# Autodesk Inventor assembly: Cantoneira dupla perfil
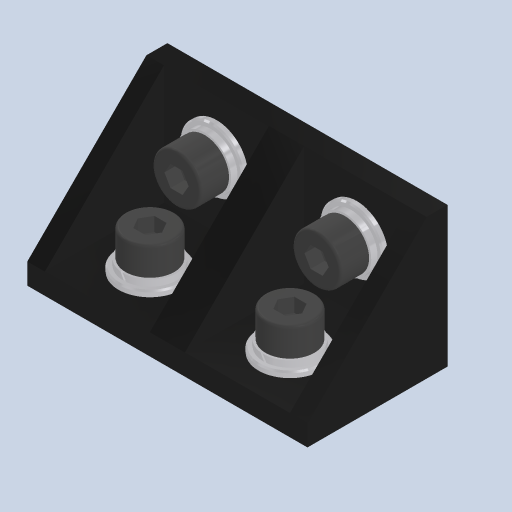
[picture p0: Inventor's stored thumbnail of the model, 512x512]
Saved by Autodesk Inventor 2024.3 (Build 283343000, 343)
## iProperties
Created: 2025-02-22
Part Number: Cantoneira dupla perfil
Document SubType Name: Assembly
Designer: Cliente
Author: Cliente
## Documents named in this file (6)
- C:\Users\Cliente\Desktop\TCC\Base\Fixação\Cantoneira dupla perfil.iam
- C:\Users\Cliente\Desktop\TCC\Base\Impresso\Cantoneira dupla perfil.ipt
- C:\Users\Cliente\Desktop\TCC\Base\Fixação\Arruela lisa DIN 125 B M4.ipt
- C:\Users\Cliente\Desktop\TCC\Base\Fixação\Arruela de pressão DIN 127 B M4.ipt
- C:\Users\Cliente\Desktop\TCC\Base\Fixação\Parafuso allen cabeça cilíndrica DIN 912 M4x10.ipt
- C:\Users\Cliente\Desktop\TCC\Base\Fixação\Porca martelo M4 canal 6.ipt
## Components (17 placed, 5 different names)
1. Cantoneira dupla perfil:1 — Alinhado:1, Alinhado:2, Alinhado:3, Coincidente:1, Coincidente:2, Coincidente:3, Coincidente:4, Coincidente:5, Coincidente:6, Coincidente:7, Coincidente:8, Ângulo:9, Ângulo:10, Ângulo:11, Ângulo:12, Coincidente:26, Ângulo:13, Ângulo:14, Coincidente:28, Coincidente:30, Ângulo:15, Ângulo:16, Coincidente:32
2. Arruela lisa DIN 125 B M4:1 — Coincidente:1, Coincidente:5, Ângulo:1, Coincidente:9, Coincidente:13
3. Arruela lisa DIN 125 B M4:2 — Coincidente:2, Coincidente:6, Ângulo:2, Coincidente:10, Coincidente:14
4. Arruela lisa DIN 125 B M4:3 — Coincidente:3, Coincidente:7, Ângulo:3, Coincidente:11, Coincidente:15
5. Arruela lisa DIN 125 B M4:4 — Coincidente:4, Coincidente:8, Ângulo:4, Coincidente:12, Coincidente:16
6. Arruela de pressão DIN 127 B M4:1 — Coincidente:9, Coincidente:13, Ângulo:5, Coincidente:17, Coincidente:21
7. Arruela de pressão DIN 127 B M4:2 — Coincidente:10, Coincidente:14, Ângulo:6, Coincidente:18, Coincidente:22
8. Arruela de pressão DIN 127 B M4:3 — Coincidente:11, Coincidente:15, Ângulo:7, Coincidente:19, Coincidente:23
9. Arruela de pressão DIN 127 B M4:4 — Coincidente:12, Coincidente:16, Ângulo:8, Coincidente:20, Coincidente:24
10. Parafuso allen cabeça cilíndrica DIN 912 M4x10:1 — Coincidente:17, Coincidente:21, Ângulo:9, Coincidente:25
11. Parafuso allen cabeça cilíndrica DIN 912 M4x10:2 — Coincidente:18, Coincidente:22, Ângulo:11, Coincidente:27
12. Parafuso allen cabeça cilíndrica DIN 912 M4x10:3 — Coincidente:19, Coincidente:23, Ângulo:10, Coincidente:29
13. Parafuso allen cabeça cilíndrica DIN 912 M4x10:4 — Coincidente:20, Coincidente:24, Ângulo:12, Coincidente:31
14. Porca martelo M4 canal 6:1 — Coincidente:25, Coincidente:26, Ângulo:13
15. Porca martelo M4 canal 6:2 — Coincidente:27, Ângulo:14, Coincidente:28
16. Porca martelo M4 canal 6:3 — Coincidente:29, Coincidente:30, Ângulo:15
17. Porca martelo M4 canal 6:4 — Coincidente:31, Ângulo:16, Coincidente:32
## Relationships (51: Mate 32, Angle 16, Flush 3)
- Alinhado:1 [Flush]: Cantoneira dupla perfil:1
- Alinhado:2 [Flush]: Cantoneira dupla perfil:1
- Alinhado:3 [Flush]: Cantoneira dupla perfil:1
- Coincidente:1 [Mate]: Cantoneira dupla perfil:1 ↔ Arruela lisa DIN 125 B M4:1
- Coincidente:2 [Mate]: Cantoneira dupla perfil:1 ↔ Arruela lisa DIN 125 B M4:2
- Coincidente:3 [Mate]: Cantoneira dupla perfil:1 ↔ Arruela lisa DIN 125 B M4:3
- Coincidente:4 [Mate]: Cantoneira dupla perfil:1 ↔ Arruela lisa DIN 125 B M4:4
- Coincidente:5 [Mate]: Cantoneira dupla perfil:1 ↔ Arruela lisa DIN 125 B M4:1
- Coincidente:6 [Mate]: Cantoneira dupla perfil:1 ↔ Arruela lisa DIN 125 B M4:2
- Coincidente:7 [Mate]: Cantoneira dupla perfil:1 ↔ Arruela lisa DIN 125 B M4:3
- Coincidente:8 [Mate]: Cantoneira dupla perfil:1 ↔ Arruela lisa DIN 125 B M4:4
- Ângulo:1 [Angle] (0 deg): Arruela lisa DIN 125 B M4:1
- Ângulo:2 [Angle] (0 deg): Arruela lisa DIN 125 B M4:2
- Ângulo:3 [Angle] (0 deg): Arruela lisa DIN 125 B M4:3
- Ângulo:4 [Angle] (0 deg): Arruela lisa DIN 125 B M4:4
- Coincidente:9 [Mate]: Arruela lisa DIN 125 B M4:1 ↔ Arruela de pressão DIN 127 B M4:1
- Coincidente:10 [Mate]: Arruela lisa DIN 125 B M4:2 ↔ Arruela de pressão DIN 127 B M4:2
- Coincidente:11 [Mate]: Arruela lisa DIN 125 B M4:3 ↔ Arruela de pressão DIN 127 B M4:3
- Coincidente:12 [Mate]: Arruela lisa DIN 125 B M4:4 ↔ Arruela de pressão DIN 127 B M4:4
- Coincidente:13 [Mate]: Arruela lisa DIN 125 B M4:1 ↔ Arruela de pressão DIN 127 B M4:1
- Coincidente:14 [Mate]: Arruela lisa DIN 125 B M4:2 ↔ Arruela de pressão DIN 127 B M4:2
- Coincidente:15 [Mate]: Arruela lisa DIN 125 B M4:3 ↔ Arruela de pressão DIN 127 B M4:3
- Coincidente:16 [Mate]: Arruela lisa DIN 125 B M4:4 ↔ Arruela de pressão DIN 127 B M4:4
- Ângulo:5 [Angle] (0 deg): Arruela de pressão DIN 127 B M4:1
- Ângulo:6 [Angle] (0 deg): Arruela de pressão DIN 127 B M4:2
- Ângulo:7 [Angle] (0 deg): Arruela de pressão DIN 127 B M4:3
- Ângulo:8 [Angle] (0 deg): Arruela de pressão DIN 127 B M4:4
- Coincidente:17 [Mate]: Arruela de pressão DIN 127 B M4:1 ↔ Parafuso allen cabeça cilíndrica DIN 912 M4x10:1
- Coincidente:18 [Mate]: Arruela de pressão DIN 127 B M4:2 ↔ Parafuso allen cabeça cilíndrica DIN 912 M4x10:2
- Coincidente:19 [Mate]: Arruela de pressão DIN 127 B M4:3 ↔ Parafuso allen cabeça cilíndrica DIN 912 M4x10:3
- Coincidente:20 [Mate]: Arruela de pressão DIN 127 B M4:4 ↔ Parafuso allen cabeça cilíndrica DIN 912 M4x10:4
- Coincidente:21 [Mate]: Arruela de pressão DIN 127 B M4:1 ↔ Parafuso allen cabeça cilíndrica DIN 912 M4x10:1
- Coincidente:22 [Mate]: Arruela de pressão DIN 127 B M4:2 ↔ Parafuso allen cabeça cilíndrica DIN 912 M4x10:2
- Coincidente:23 [Mate]: Arruela de pressão DIN 127 B M4:3 ↔ Parafuso allen cabeça cilíndrica DIN 912 M4x10:3
- Coincidente:24 [Mate]: Arruela de pressão DIN 127 B M4:4 ↔ Parafuso allen cabeça cilíndrica DIN 912 M4x10:4
- Ângulo:9 [Angle] (0 deg): Cantoneira dupla perfil:1 ↔ Parafuso allen cabeça cilíndrica DIN 912 M4x10:1
- Ângulo:10 [Angle] (0 deg): Cantoneira dupla perfil:1 ↔ Parafuso allen cabeça cilíndrica DIN 912 M4x10:3
- Ângulo:11 [Angle] (0 deg): Cantoneira dupla perfil:1 ↔ Parafuso allen cabeça cilíndrica DIN 912 M4x10:2
- Ângulo:12 [Angle] (0 deg): Cantoneira dupla perfil:1 ↔ Parafuso allen cabeça cilíndrica DIN 912 M4x10:4
- Coincidente:25 [Mate]: Parafuso allen cabeça cilíndrica DIN 912 M4x10:1 ↔ Porca martelo M4 canal 6:1
- Coincidente:26 [Mate] (1.8 mm): Cantoneira dupla perfil:1 ↔ Porca martelo M4 canal 6:1
- Ângulo:13 [Angle] (0 deg): Cantoneira dupla perfil:1 ↔ Porca martelo M4 canal 6:1
- Coincidente:27 [Mate]: Parafuso allen cabeça cilíndrica DIN 912 M4x10:2 ↔ Porca martelo M4 canal 6:2
- Ângulo:14 [Angle] (0 deg): Cantoneira dupla perfil:1 ↔ Porca martelo M4 canal 6:2
- Coincidente:28 [Mate] (1.8 mm): Cantoneira dupla perfil:1 ↔ Porca martelo M4 canal 6:2
- Coincidente:29 [Mate]: Parafuso allen cabeça cilíndrica DIN 912 M4x10:3 ↔ Porca martelo M4 canal 6:3
- Coincidente:30 [Mate] (1.8 mm): Cantoneira dupla perfil:1 ↔ Porca martelo M4 canal 6:3
- Ângulo:15 [Angle] (0 deg): Cantoneira dupla perfil:1 ↔ Porca martelo M4 canal 6:3
- Coincidente:31 [Mate]: Parafuso allen cabeça cilíndrica DIN 912 M4x10:4 ↔ Porca martelo M4 canal 6:4
- Ângulo:16 [Angle] (0 deg): Cantoneira dupla perfil:1 ↔ Porca martelo M4 canal 6:4
- Coincidente:32 [Mate] (1.8 mm): Cantoneira dupla perfil:1 ↔ Porca martelo M4 canal 6:4
